# Autodesk Inventor assembly: CDJ2B10
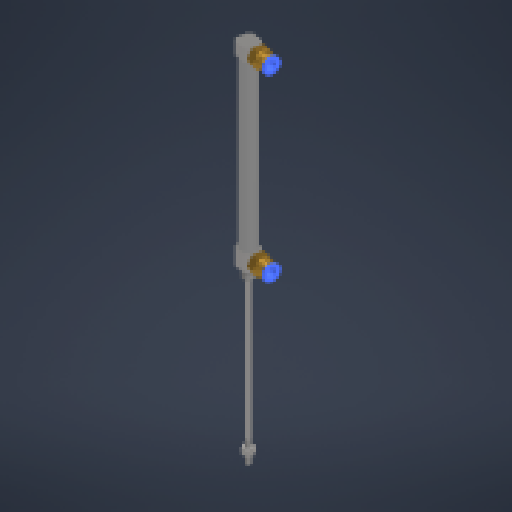
[picture p0: Inventor's stored thumbnail of the model, 512x512]
Saved by Autodesk Inventor 2026.2 (Build 302298010, 298A)
## iProperties
Created: 2026-05-08
Part Number: CDJ2B10
Document SubType Name: Assembly
Designer: work
Author: work
## Documents named in this file (3)
- C:\Users\work\Desktop\ARD_v1\ARD_hardware\PneumaticGripper_v1\Pneumatic fitting\CDJ2B10_100\CDJ2B10.iam
- C:\Users\work\Desktop\ARD_v1\ARD_hardware\PneumaticGripper_v1\Pneumatic fitting\CDJ2B10_100\CDJ2B10_Body.ipt
- C:\Users\work\Desktop\ARD_v1\ARD_hardware\PneumaticGripper_v1\Pneumatic fitting\PC6-M5.ipt
## Components (3 placed, 2 different names)
1. CDJ2B10_Body:1 — 회전:1, 회전:2
2. PC6-M5:1 — 회전:1
3. PC6-M5:2 — 회전:2
## Relationships (2: RevoluteJoint 2)
- 회전:1 [RevoluteJoint]: CDJ2B10_Body:1 ↔ PC6-M5:1
- 회전:2 [RevoluteJoint]: CDJ2B10_Body:1 ↔ PC6-M5:2
